# Autodesk Inventor assembly: 1_pont
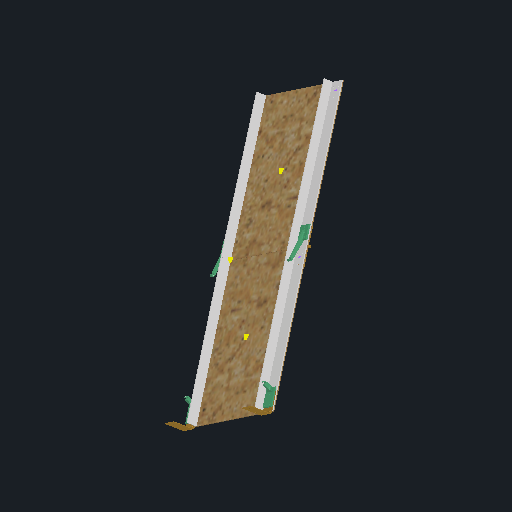
[picture p0: Inventor's stored thumbnail of the model, 512x512]
Saved by Autodesk Inventor 2026 (Build 300175000, 175)
## iProperties
Created: 2025-05-06
Part Number: 1_pont
Document SubType Name: Assembly
Designer: remg9
Author: remg9
## Documents named in this file (8)
- C:\Users\remg9\OneDrive - HESSO\P2511_Dossier_partage_RVEZ\01_Robot\0101_CAO\01_pont\1_pont.iam
- C:\Users\remg9\OneDrive - HESSO\P2511_Dossier_partage_RVEZ\01_Robot\0101_CAO\01_pont\1_1_2_1_profile_L_D.ipt
- C:\Users\remg9\OneDrive - HESSO\P2511_Dossier_partage_RVEZ\01_Robot\0101_CAO\01_pont\1_1_charniere.iam
- C:\Users\remg9\OneDrive - HESSO\P2511_Dossier_partage_RVEZ\01_Robot\0101_CAO\01_pont\1_1_2_2_profile_L_G.ipt
- C:\Users\remg9\OneDrive - HESSO\P2511_Dossier_partage_RVEZ\01_Robot\0101_CAO\01_pont\1_1_3_plaque.ipt
- C:\Users\remg9\OneDrive - HESSO\P2511_Dossier_partage_RVEZ\01_Robot\0101_CAO\01_pont\1_1_5_attache_ressort.ipt
- C:\Users\remg9\OneDrive - HESSO\P2511_Dossier_partage_RVEZ\01_Robot\0101_CAO\01_pont\1_1_5_2_attache_ressort_robot.ipt
- C:\Users\remg9\OneDrive - HESSO\P2511_Dossier_partage_RVEZ\01_Robot\0101_CAO\01_pont\1_1_2_charniere.iam
## Components (14 placed, 7 different names)
1. 1_1_2_1_profile_L_D:1 — Insert:1, Insert:2, Insert:5, Insert:6, Mate:1
2. 1_1_2_1_profile_L_D:2 — Insert:17, Insert:18, Insert:23, Insert:24
3. 1_1_charniere:1 [sub-assembly] — Insert:9, Insert:10, Insert:13, Insert:14
4. 1_1_charniere:2 [sub-assembly] — Insert:11, Insert:12, Insert:15, Insert:16
5. 1_1_2_charniere:2 [sub-assembly] — Insert:1, Insert:2, Mate:1, Insert:27, Insert:28
6. 1_1_2_charniere:1 [sub-assembly] — Insert:3, Insert:4, Insert:29, Insert:30, Mate:2
7. 1_1_2_2_profile_L_G:1 — Insert:3, Insert:4, Insert:7, Insert:8, Mate:2
8. 1_1_2_2_profile_L_G:2 — Insert:19, Insert:20, Insert:21, Insert:22
9. 1_1_3_plaque:1 — Insert:5, Insert:6, Insert:7, Insert:8, Insert:9, Insert:10, Insert:11, Insert:12, Angle:3
10. 1_1_3_plaque:2 — Insert:13, Insert:14, Insert:15, Insert:16, Insert:17, Insert:18, Insert:19, Insert:20, Angle:3
11. 1_1_5_attache_ressort:1 — Insert:21, Insert:22
12. 1_1_5_attache_ressort:2 — Insert:23, Insert:24
13. 1_1_5_2_attache_ressort_robot:1 — Insert:27, Insert:28
14. 1_1_5_2_attache_ressort_robot:2 — Insert:29, Insert:30
## Relationships (31: Insert 28, Mate 2, Angle 1)
- Insert:1: 1_1_2_1_profile_L_D:1 ↔ 1_1_2_charniere:2
- Insert:2: 1_1_2_1_profile_L_D:1 ↔ 1_1_2_charniere:2
- Insert:3: 1_1_2_charniere:1 ↔ 1_1_2_2_profile_L_G:1
- Insert:4: 1_1_2_charniere:1 ↔ 1_1_2_2_profile_L_G:1
- Insert:5: 1_1_2_1_profile_L_D:1 ↔ 1_1_3_plaque:1
- Insert:6: 1_1_2_1_profile_L_D:1 ↔ 1_1_3_plaque:1
- Insert:7: 1_1_2_2_profile_L_G:1 ↔ 1_1_3_plaque:1
- Insert:8: 1_1_2_2_profile_L_G:1 ↔ 1_1_3_plaque:1
- Insert:9: 1_1_charniere:1 ↔ 1_1_3_plaque:1
- Insert:10: 1_1_charniere:1 ↔ 1_1_3_plaque:1
- Insert:11: 1_1_charniere:2 ↔ 1_1_3_plaque:1
- Insert:12: 1_1_charniere:2 ↔ 1_1_3_plaque:1
- Insert:13: 1_1_charniere:1 ↔ 1_1_3_plaque:2
- Insert:14: 1_1_charniere:1 ↔ 1_1_3_plaque:2
- Insert:15: 1_1_charniere:2 ↔ 1_1_3_plaque:2
- Insert:16: 1_1_charniere:2 ↔ 1_1_3_plaque:2
- Insert:17: 1_1_2_1_profile_L_D:2 ↔ 1_1_3_plaque:2
- Insert:18: 1_1_2_1_profile_L_D:2 ↔ 1_1_3_plaque:2
- Insert:19: 1_1_2_2_profile_L_G:2 ↔ 1_1_3_plaque:2
- Insert:20: 1_1_2_2_profile_L_G:2 ↔ 1_1_3_plaque:2
- Insert:21: 1_1_2_2_profile_L_G:2 ↔ 1_1_5_attache_ressort:1
- Insert:22: 1_1_2_2_profile_L_G:2 ↔ 1_1_5_attache_ressort:1
- Insert:23: 1_1_2_1_profile_L_D:2 ↔ 1_1_5_attache_ressort:2
- Insert:24: 1_1_2_1_profile_L_D:2 ↔ 1_1_5_attache_ressort:2
- Mate:1: 1_1_2_1_profile_L_D:1 ↔ 1_1_2_charniere:2
- Insert:27: 1_1_2_charniere:2 ↔ 1_1_5_2_attache_ressort_robot:1
- Insert:28: 1_1_2_charniere:2 ↔ 1_1_5_2_attache_ressort_robot:1
- Insert:29: 1_1_2_charniere:1 ↔ 1_1_5_2_attache_ressort_robot:2
- Insert:30: 1_1_2_charniere:1 ↔ 1_1_5_2_attache_ressort_robot:2
- Angle:3 (15 deg): 1_1_3_plaque:1 ↔ 1_1_3_plaque:2
- Mate:2: 1_1_2_charniere:1 ↔ 1_1_2_2_profile_L_G:1
